# Autodesk Inventor assembly: Cabling_Module_Top_V1.3
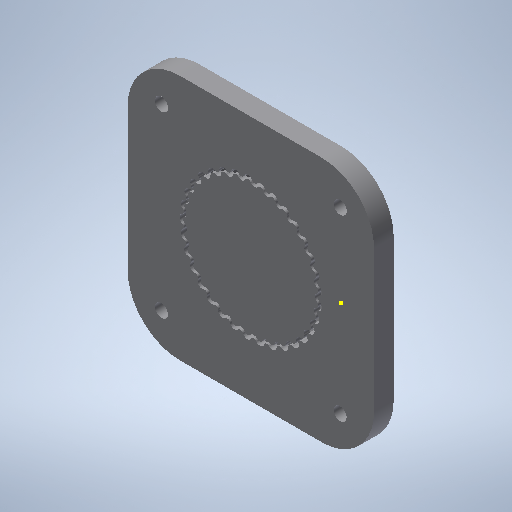
[picture p0: Inventor's stored thumbnail of the model, 512x512]
Saved by Autodesk Inventor 2025.2 (Build 292293000, 293)
## iProperties
Created: 2026-02-25
Part Number: Cabling_Module_Top_V1.3
Document SubType Name: Assembly
Designer: crazi
Author: crazi
## Documents named in this file (3)
- D:\Family\Arav\Projects\3D_Gridfinity\Cabling\Assembly\Cabling_Module_Top_V1.2\Cabling_Module_Top_V1.3.iam
- D:\Family\Arav\Projects\3D_Gridfinity\Cabling\Assembly\Cabling_Module_Top_V1.2\Cabling_Module_Top_V1.2_Base.ipt
- D:\Family\Arav\Projects\3D_Gridfinity\Cabling\Assembly\Cabling_Module_Top_V1.2\Cabling_Module_Top_V1.2_Top.ipt
## Components (2 placed, 2 different names)
1. Cabling_Module_Top_V1.2_Base:1 — Flush:1, Flush:2, Mate:1
2. Cabling_Module_Top_V1.2_Top:1 — Flush:1, Flush:2, Mate:1
## Relationships (3: Flush 2, Mate 1)
- Flush:1: Cabling_Module_Top_V1.2_Base:1 ↔ Cabling_Module_Top_V1.2_Top:1
- Flush:2: Cabling_Module_Top_V1.2_Base:1 ↔ Cabling_Module_Top_V1.2_Top:1
- Mate:1 (-0.05 mm): Cabling_Module_Top_V1.2_Base:1 ↔ Cabling_Module_Top_V1.2_Top:1
